# Autodesk Inventor assembly: chelun
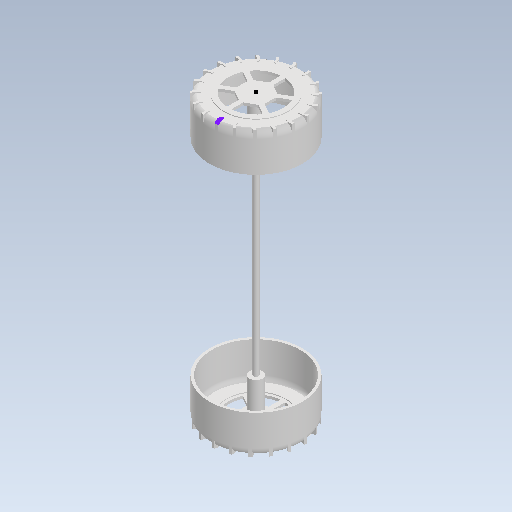
[picture p0: Inventor's stored thumbnail of the model, 512x512]
Saved by Autodesk Inventor 2021 (Build 250183000, 183)
## iProperties
Created: 2024-05-08
Part Number: chelun
Document SubType Name: Assembly
Designer: admin
Author: admin
## Documents named in this file (3)
- E:\月球车模型-许诺\chelun.iam
- E:\月球车模型-许诺\月球车模型-姓名\轮子(36mm).ipt
- E:\月球车模型-许诺\月球车模型-姓名\轴(2mm 80mm).ipt
## Components (3 placed, 2 different names)
1. 轮子(36mm):1 — 旋转:1
2. 轮子(36mm):2 — 插入:1
3. 轴(2mm 80mm):1 — 旋转:1, 插入:1
## Relationships (2: RevoluteJoint 1, Insert 1)
- 旋转:1 [RevoluteJoint]: 轮子(36mm):1 ↔ 轴(2mm 80mm):1
- 插入:1 [Insert]: 轮子(36mm):2 ↔ 轴(2mm 80mm):1
